# Autodesk Inventor assembly: SPE2V1 Baranda (soldadura)
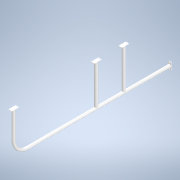
[picture p0: Inventor's stored thumbnail of the model, 180x180]
Saved by Autodesk Inventor 2021.2 (Build 252289000, 289)
## iProperties
Created: 2026-06-02
Part Number: SPE2V1 Baranda (soldadura)
Document SubType Name: Assembly
Designer: nelso
Author: nelso
## Documents named in this file (4)
- C:\Users\nelso\Documents\Escritorio\Soporte-Paciente-Espinografia\Workspace\SPE2V1 Baranda (soldadura).iam
- C:\Users\nelso\Documents\Escritorio\Soporte-Paciente-Espinografia\Workspace\SP39V1 Tubo Baranda.ipt
- C:\Users\nelso\Documents\Escritorio\Soporte-Paciente-Espinografia\Workspace\SP38V1 Agarre Baranda.ipt
- C:\Users\nelso\Documents\Escritorio\Soporte-Paciente-Espinografia\Workspace\SP37V1 Planchuela Baranda.ipt
## Components (7 placed, 3 different names)
1. SP37V1 Planchuela Baranda:1 — Mate:8, Mate:9, Mate:10
2. SP37V1 Planchuela Baranda:2 — Coincidencia:14, Coincidencia:15, Coincidencia:16
3. SP37V1 Planchuela Baranda:3 — Mate:11, Mate:12, Mate:13
4. SP37V1 Planchuela Baranda:4 — Coincidencia:17, Coincidencia:18, Coincidencia:19
5. SP38V1 Agarre Baranda:1 — Mate:4, Mate:7, Mate:9, Mate:10, Mate:20
6. SP38V1 Agarre Baranda:2 — Mate:3, Mate:6, Mate:12, Mate:13, Mate:21
7. SP39V1 Tubo Baranda:1 — Mate:3, Mate:4, Mate:5, Coincidencia:15, Coincidencia:16, Coincidencia:17, Coincidencia:18, Mate:20, Mate:21, Mate:22
## Relationships (20: Mate 20)
- Mate:3 (-500 mm): SP38V1 Agarre Baranda:2 ↔ SP39V1 Tubo Baranda:1
- Mate:4 (-800 mm): SP38V1 Agarre Baranda:1 ↔ SP39V1 Tubo Baranda:1
- Mate:5: SP39V1 Tubo Baranda:1
- Mate:6: SP38V1 Agarre Baranda:2
- Mate:7: SP38V1 Agarre Baranda:1
- Mate:8: SP37V1 Planchuela Baranda:1
- Mate:9: SP37V1 Planchuela Baranda:1 ↔ SP38V1 Agarre Baranda:1
- Mate:10: SP37V1 Planchuela Baranda:1 ↔ SP38V1 Agarre Baranda:1
- Mate:11: SP37V1 Planchuela Baranda:3
- Mate:12: SP37V1 Planchuela Baranda:3 ↔ SP38V1 Agarre Baranda:2
- Mate:13: SP37V1 Planchuela Baranda:3 ↔ SP38V1 Agarre Baranda:2
- Coincidencia:14 [Mate]: SP37V1 Planchuela Baranda:2
- Coincidencia:15 [Mate]: SP37V1 Planchuela Baranda:2 ↔ SP39V1 Tubo Baranda:1
- Coincidencia:16 [Mate]: SP37V1 Planchuela Baranda:2 ↔ SP39V1 Tubo Baranda:1
- Coincidencia:17 [Mate]: SP37V1 Planchuela Baranda:4 ↔ SP39V1 Tubo Baranda:1
- Coincidencia:18 [Mate]: SP37V1 Planchuela Baranda:4 ↔ SP39V1 Tubo Baranda:1
- Coincidencia:19 [Mate]: SP37V1 Planchuela Baranda:4
- Mate:20: SP38V1 Agarre Baranda:1 ↔ SP39V1 Tubo Baranda:1
- Mate:21: SP38V1 Agarre Baranda:2 ↔ SP39V1 Tubo Baranda:1
- Mate:22: SP39V1 Tubo Baranda:1
